# Autodesk Inventor assembly: obudowa
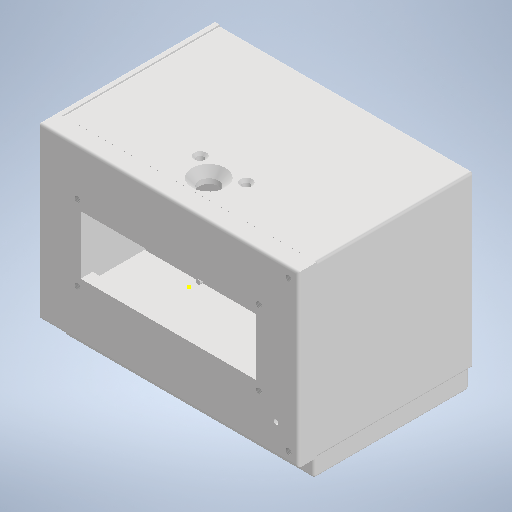
[picture p0: Inventor's stored thumbnail of the model, 512x512]
Saved by Autodesk Inventor 2025.2 (Build 292293000, 293)
## iProperties
Created: 2026-10-26
Part Number: obudowa
Document SubType Name: Assembly
Designer: Kacper
Author: Kacper
## Documents named in this file (4)
- D:\studia\inzynierka\obudowa.iam
- D:\studia\inzynierka\pudelkov2.ipt
- D:\studia\inzynierka\polka.ipt
- D:\studia\inzynierka\gora.ipt
## Components (3 placed, 3 different names)
1. pudelkov2:1 — Mate:1, Mate:2, Flush:1, Mate:3, Mate:4, Mate:5
2. polka:1 — Mate:1, Mate:2, Flush:1
3. gora:1 — Mate:3, Mate:4, Mate:5
## Relationships (6: Mate 5, Flush 1)
- Mate:1: pudelkov2:1 ↔ polka:1
- Mate:2: pudelkov2:1 ↔ polka:1
- Flush:1: pudelkov2:1 ↔ polka:1
- Mate:3: pudelkov2:1 ↔ gora:1
- Mate:4: pudelkov2:1 ↔ gora:1
- Mate:5: pudelkov2:1 ↔ gora:1
